# Autodesk Inventor assembly: DCDC_unit
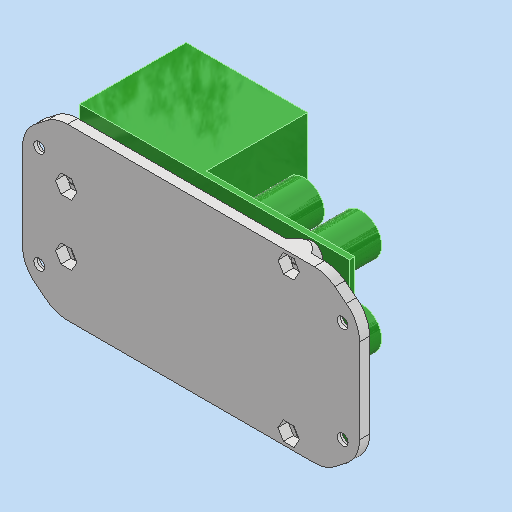
[picture p0: Inventor's stored thumbnail of the model, 512x512]
Saved by Autodesk Inventor 2025.3 (Build 293356030, 356C)
## iProperties
Created: 2025-08-01
Part Number: DCDC_unit
Document SubType Name: Assembly
Designer: ibuki_ono
Author: ibuki_ono
## Documents named in this file (3)
- C:\Users\ibuki_ono\Documents\hobby\rogiken\catchrobo\CAD\Hardware_CAD\Inventor\circuit\DCDC_unit.iam
- C:\Users\ibuki_ono\Documents\hobby\rogiken\catchrobo\CAD\Hardware_CAD\Inventor\circuit\12V_DCDC.ipt
- C:\Users\ibuki_ono\Documents\hobby\rogiken\catchrobo\CAD\Hardware_CAD\Inventor\circuit\3D_DC_fix.ipt
## Components (2 placed, 2 different names)
1. 12V_DCDC:1 — フラッシュ:1, フラッシュ:2
2. 3D_DC_fix:1 — フラッシュ:1, フラッシュ:2
## Relationships (2: Flush 2)
- フラッシュ:1 [Flush]: 12V_DCDC:1 ↔ 3D_DC_fix:1
- フラッシュ:2 [Flush] (4 mm): 12V_DCDC:1 ↔ 3D_DC_fix:1
